# Autodesk Inventor assembly: oči + nos
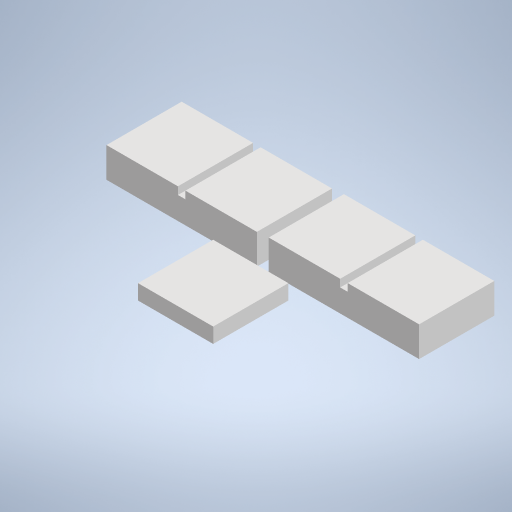
[picture p0: Inventor's stored thumbnail of the model, 512x512]
Saved by Autodesk Inventor 2024 (Build 280153000, 153)
## iProperties
Created: 2025-11-11
Part Number: oči + nos
Document SubType Name: Assembly
Designer: zak
Author: zak
## Documents named in this file (3)
- D:\Podpleský\oči + nos.iam
- D:\Podpleský\oko.ipt
- D:\Podpleský\Nos.ipt
## Components (3 placed, 2 different names)
1. oko:1 — Proti sobě:2
2. oko:2 — Proti sobě:3
3. Nos:1 — Proti sobě:1
## Relationships (3: Mate 3)
- Proti sobě:1 [Mate]: Nos:1
- Proti sobě:2 [Mate]: oko:1
- Proti sobě:3 [Mate]: oko:2
